# Autodesk Inventor assembly: EG
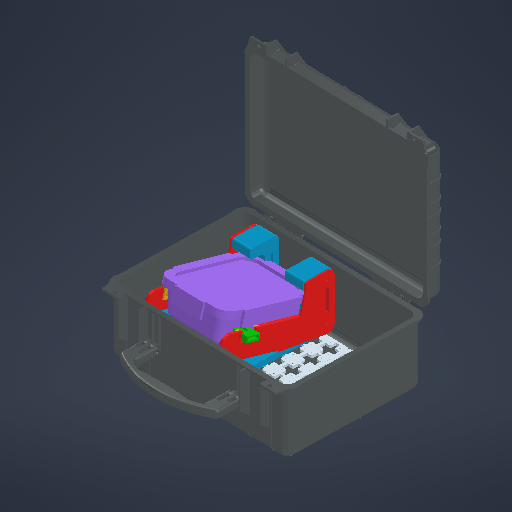
[picture p0: Inventor's stored thumbnail of the model, 512x512]
Saved by Autodesk Inventor 2026.1 (Build 301233020, 233B)
## iProperties
Created: 2026-06-04
Part Number: EG
Document SubType Name: Assembly
Designer: matpo
Author: matpo
## Documents named in this file (11)
- C:\Users\matpo\OneDrive - HESSO\2Annee\Projet_Thématique_PB0326\2_Partie_Mecanique\Meca finale\assemblage_grille_valise_supp.asm\assemblage_grille_valise_supp\EG.iam
- C:\Users\matpo\OneDrive - HESSO\2Annee\Projet_Thématique_PB0326\2_Partie_Mecanique\Meca finale\assemblage_grille_valise_supp.asm\assemblage_grille_valise_supp\MALETTE.iam
- C:\Users\matpo\OneDrive - HESSO\2Annee\Projet_Thématique_PB0326\2_Partie_Mecanique\Meca finale\assemblage_grille_valise_supp.asm\assemblage_grille_valise_supp\GRIDFINITY_PLAQUE.ipt
- C:\Users\matpo\OneDrive - HESSO\2Annee\Projet_Thématique_PB0326\2_Partie_Mecanique\Meca finale\assemblage_grille_valise_supp.asm\assemblage_grille_valise_supp\SUPPORT_FINAL.ipt
- C:\Users\matpo\OneDrive - HESSO\2Annee\Projet_Thématique_PB0326\2_Partie_Mecanique\cote_tup_support.ipt
- C:\Users\matpo\OneDrive - HESSO\2Annee\Projet_Thématique_PB0326\2_Partie_Mecanique\EG_Tup.iam
- C:\Users\matpo\OneDrive - HESSO\2Annee\Projet_Thématique_PB0326\2_Partie_Mecanique\impression\support_cable_aimant.ipt
- C:\Users\matpo\OneDrive - HESSO\2Annee\Projet_Thématique_PB0326\2_Partie_Mecanique\impression\support_aimant_chargeur.ipt
- C:\Users\matpo\OneDrive - HESSO\2Annee\Projet_Thématique_PB0326\2_Partie_Mecanique\impression\porte_aimant_peltier.ipt
- C:\Users\matpo\OneDrive - HESSO\2Annee\Projet_Thématique_PB0326\2_Partie_Mecanique\impression\support_peltier_boite.ipt
- C:\Users\matpo\OneDrive - HESSO\2Annee\Projet_Thématique_PB0326\2_Partie_Mecanique\cote_tup_support_MIR.ipt
## Components (15 placed, 10 different names)
1. MALETTE [sub-assembly] — Placage:18, Placage:19, Placage:20, Placage:21
2. GRIDFINITY_PLAQUE — Affleurement:3, Affleurement:4, Placage:5, Placage:6, Placage:7, Placage:19
3. GRIDFINITY_PLAQUE:1 — Affleurement:1, Affleurement:2, Placage:4, Affleurement:3, Affleurement:4, Placage:5, Placage:8, Placage:9, Placage:10, Placage:20
4. GRIDFINITY_PLAQUE:2 — Placage:1, Affleurement:1, Affleurement:2, Placage:4, Placage:18
5. SUPPORT_FINAL — Placage:8, Placage:9, Placage:10, Affleurement:5, Affleurement:6, Placage:15, Affleurement:7, Affleurement:15, Affleurement:16
6. SUPPORT_FINAL:1 — Placage:1, Placage:6, Placage:7, Placage:17, Placage:22
7. cote_tup_support:1 — Affleurement:5, Affleurement:6, Affleurement:7, Affleurement:9, Affleurement:10, Affleurement:11, Affleurement:12, Affleurement:13, Affleurement:14, Affleurement:18, Affleurement:19, Affleurement:20, Affleurement:21
8. EG_Tup:1 [sub-assembly] — Placage:15, Placage:17, Affleurement:9, Affleurement:10, Affleurement:17, Placage:26
9. support_cable_aimant:1 — Affleurement:11, Affleurement:12
10. support_aimant_chargeur:1 — Affleurement:13, Affleurement:14
11. porte_aimant_peltier:1 — Affleurement:15, Affleurement:16
12. support_peltier_boite:1 — Affleurement:17
13. cote_tup_support_MIR:1 — Affleurement:18, Affleurement:19, Affleurement:20, Affleurement:21, Placage:22, Placage:23, Affleurement:22, Affleurement:23, Placage:24, Placage:25
14. support_cable_aimant:2 — Placage:23, Affleurement:22, Affleurement:23
15. support_aimant_chargeur:2 — Placage:24, Placage:25, Placage:26
## Relationships (41: Flush 22, Mate 19)
- Placage:1 [Mate]: GRIDFINITY_PLAQUE:2 ↔ SUPPORT_FINAL:1
- Affleurement:1 [Flush]: GRIDFINITY_PLAQUE:1 ↔ GRIDFINITY_PLAQUE:2
- Affleurement:2 [Flush]: GRIDFINITY_PLAQUE:1 ↔ GRIDFINITY_PLAQUE:2
- Placage:4 [Mate]: GRIDFINITY_PLAQUE:1 ↔ GRIDFINITY_PLAQUE:2
- Affleurement:3 [Flush]: GRIDFINITY_PLAQUE ↔ GRIDFINITY_PLAQUE:1
- Affleurement:4 [Flush]: GRIDFINITY_PLAQUE ↔ GRIDFINITY_PLAQUE:1
- Placage:5 [Mate]: GRIDFINITY_PLAQUE ↔ GRIDFINITY_PLAQUE:1
- Placage:6 [Mate]: GRIDFINITY_PLAQUE ↔ SUPPORT_FINAL:1
- Placage:7 [Mate]: GRIDFINITY_PLAQUE ↔ SUPPORT_FINAL:1
- Placage:8 [Mate]: GRIDFINITY_PLAQUE:1 ↔ SUPPORT_FINAL
- Placage:9 [Mate]: GRIDFINITY_PLAQUE:1 ↔ SUPPORT_FINAL
- Placage:10 [Mate]: GRIDFINITY_PLAQUE:1 ↔ SUPPORT_FINAL
- Affleurement:5 [Flush]: SUPPORT_FINAL ↔ cote_tup_support:1
- Affleurement:6 [Flush]: SUPPORT_FINAL ↔ cote_tup_support:1
- Placage:15 [Mate]: SUPPORT_FINAL ↔ EG_Tup:1
- Placage:17 [Mate] (5 mm): SUPPORT_FINAL:1 ↔ EG_Tup:1
- Placage:18 [Mate]: MALETTE ↔ GRIDFINITY_PLAQUE:2
- Placage:19 [Mate] (15 mm): MALETTE ↔ GRIDFINITY_PLAQUE
- Placage:20 [Mate] (15 mm): MALETTE ↔ GRIDFINITY_PLAQUE:1
- Placage:21 [Mate]: MALETTE
- Affleurement:7 [Flush]: SUPPORT_FINAL ↔ cote_tup_support:1
- Affleurement:9 [Flush] (-100 mm): cote_tup_support:1 ↔ EG_Tup:1
- Affleurement:10 [Flush]: cote_tup_support:1 ↔ EG_Tup:1
- Affleurement:11 [Flush]: cote_tup_support:1 ↔ support_cable_aimant:1
- Affleurement:12 [Flush]: cote_tup_support:1 ↔ support_cable_aimant:1
- Affleurement:13 [Flush]: cote_tup_support:1 ↔ support_aimant_chargeur:1
- Affleurement:14 [Flush]: cote_tup_support:1 ↔ support_aimant_chargeur:1
- Affleurement:15 [Flush]: SUPPORT_FINAL ↔ porte_aimant_peltier:1
- Affleurement:16 [Flush]: SUPPORT_FINAL ↔ porte_aimant_peltier:1
- Affleurement:17 [Flush]: EG_Tup:1 ↔ support_peltier_boite:1
- Affleurement:18 [Flush]: cote_tup_support:1 ↔ cote_tup_support_MIR:1
- Affleurement:19 [Flush]: cote_tup_support:1 ↔ cote_tup_support_MIR:1
- Affleurement:20 [Flush]: cote_tup_support:1 ↔ cote_tup_support_MIR:1
- Affleurement:21 [Flush]: cote_tup_support:1 ↔ cote_tup_support_MIR:1
- Placage:22 [Mate]: SUPPORT_FINAL:1 ↔ cote_tup_support_MIR:1
- Placage:23 [Mate]: cote_tup_support_MIR:1 ↔ support_cable_aimant:2
- Affleurement:22 [Flush]: cote_tup_support_MIR:1 ↔ support_cable_aimant:2
- Affleurement:23 [Flush]: cote_tup_support_MIR:1 ↔ support_cable_aimant:2
- Placage:24 [Mate]: cote_tup_support_MIR:1 ↔ support_aimant_chargeur:2
- Placage:25 [Mate] (1 mm): cote_tup_support_MIR:1 ↔ support_aimant_chargeur:2
- Placage:26 [Mate] (2 mm): EG_Tup:1 ↔ support_aimant_chargeur:2
